# Autodesk Inventor assembly: 3_bar_SCARA_v1
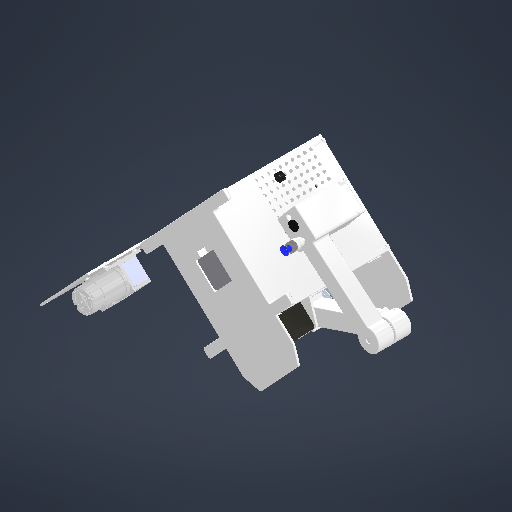
[picture p0: Inventor's stored thumbnail of the model, 512x512]
Saved by Autodesk Inventor 2026 (Build 300175050, 175E)
## iProperties
Created: 2026-10-16
Part Number: 3_bar_SCARA_v1
Document SubType Name: Assembly
Designer: Ваня
Author: Ваня
## Documents named in this file (38)
- C:\Users\VK7\Desktop\SCARA_ETZ_2027\3D Модели\Сборки\3_bar_SCARA_v1.iam
- C:\Users\VK7\Desktop\SCARA_ETZ_2027\3D Модели\Для сборки\Подшипники\pillow_block-KFL08.ipt
- C:\Users\VK7\Desktop\SCARA_ETZ_2027\3D Модели\Для печати\Шкивы\Шкив_GT2_60T_v1.ipt
- C:\Users\VK7\Desktop\SCARA_ETZ_2027\3D Модели\Для печати\Плечи\Плечо_переднее_3BAR.ipt
- C:\Users\VK7\Desktop\SCARA_ETZ_2027\3D Модели\Для сборки\Металл\Вал_алюминиевый_8x30.ipt
- C:\Users\Ваня\Documents\Inventor\Content Center Files\R2025\ru-RU\BS 4168(3)\BS 4168 - M3 x 3(3).ipt
- C:\Users\Ваня\Documents\Inventor\Content Center Files\R2025\ru-RU\AS 1474(1)\AS 1474 - M3(1).ipt
- C:\Users\Ваня\Documents\Inventor\Content Center Files\R2025\ru-RU\AS 1427(05)\AS 1427 - M3 x 16(5) II.ipt
- C:\Users\VK7\Desktop\SCARA_ETZ_2027\3D Модели\Для сборки\Моторы\17HS4401\17HS4401\17HS4401.ipt
- C:\Users\VK7\Desktop\SCARA_ETZ_2027\3D Модели\Для сборки\Подшипники\605-ZZ.ipt
- C:\Users\VK7\Desktop\SCARA_ETZ_2027\3D Модели\Для печати\Плечи\Заглушка_для_переднего_плеча.ipt
- C:\Users\VK7\Desktop\SCARA_ETZ_2027\3D Модели\Для сборки\Подшипники\KDL08_подшипник_без_ободка.ipt
- C:\Users\VK7\Desktop\SCARA_ETZ_2027\3D Модели\Для печати\Плечи\Плечо_дальнее_3BAR.ipt
- C:\Users\VK7\Desktop\SCARA_ETZ_2027\3D Модели\Для печати\Шкивы\Шкив_GT2_40T.ipt
- C:\Users\VK7\Desktop\SCARA_ETZ_2027\3D Модели\Для сборки\Металл\Вал_алюминиевый_8x49.ipt
- C:\Users\VK7\Desktop\SCARA_ETZ_2027\3D Модели\Для печати\Шкивы\Шкив_GT2_20T.ipt
- C:\Users\VK7\Desktop\SCARA_ETZ_2027\3D Модели\Для печати\Ось Z\Крышка_для_оси_Z.ipt
- C:\Users\VK7\Desktop\SCARA_ETZ_2027\3D Модели\Для печати\Ось Z\Платформа_для_оси_Z.ipt
- C:\Users\VK7\Desktop\SCARA_ETZ_2027\3D Модели\Для сборки\Металл\Ползун_для_винта.ipt
- C:\Users\VK7\Desktop\SCARA_ETZ_2027\3D Модели\Для сборки\Подшипники\LM8UU\LM8UU.iam
- C:\Users\VK7\Desktop\SCARA_ETZ_2027\3D Модели\Для сборки\Шкивы\Шкив_GT2_20T.ipt
- C:\Users\VK7\Desktop\SCARA_ETZ_2027\3D Модели\Для сборки\Моторы\Stepper with LeadScrew.ipt
- C:\Users\VK7\Desktop\SCARA_ETZ_2027\3D Модели\Для сборки\Металл\Вал_алюминиевый_8x181.ipt
- C:\Users\VK7\Desktop\SCARA_ETZ_2027\3D Модели\Для печати\Основание\Основа робота.ipt
- C:\Users\VK7\Desktop\SCARA_ETZ_2027\3D Модели\Для печати\Основание\Крышка_верхняя.ipt
- C:\Users\VK7\Desktop\SCARA_ETZ_2027\3D Модели\Для печати\Голова\Крышка_голова_верхняя.ipt
- C:\Users\VK7\Desktop\SCARA_ETZ_2027\3D Модели\Для сборки\Моторы\20HS24\20HS24\20HS24.ipt
- C:\Users\VK7\Desktop\SCARA_ETZ_2027\3D Модели\Для печати\Захват\Трубка.ipt
- C:\Users\VK7\Desktop\SCARA_ETZ_2027\3D Модели\Для сборки\Захват\Присоска\Festo_VAS-15.iam
- C:\Users\VK7\Desktop\SCARA_ETZ_2027\3D Модели\Для печати\Захват\Адаптер_для_присоски.ipt
- C:\Users\VK7\Desktop\SCARA_ETZ_2027\3D Модели\Для сборки\Другое\Камера.ipt
- C:\Users\VK7\Desktop\SCARA_ETZ_2027\3D Модели\Для сборки\Другое\Датчик_расстояния_VL53L0X.ipt
- C:\Users\VK7\Desktop\SCARA_ETZ_2027\3D Модели\Для печати\Голова\Крышка_голова_передняя.ipt
- C:\Users\VK7\Desktop\SCARA_ETZ_2027\3D Модели\Для печати\Основание\Крышка_задняя.ipt
- C:\Users\VK7\Desktop\SCARA_ETZ_2027\3D Модели\Для печати\Другое\Шестерня_для_поворота_присоски_Nema_8.ipt
- C:\Users\VK7\Desktop\SCARA_ETZ_2027\3D Модели\Для печати\Другое\Шестерня_для_поворота_присоски_.ipt
- C:\Users\VK7\Desktop\SCARA_ETZ_2027\3D Модели\Для сборки\Захват\Насос\Mini Vacuum pump-12V.ipt
- C:\Users\VK7\Desktop\SCARA_ETZ_2027\3D Модели\Для печати\Другое\Прокладка_для_насоса_TPU.ipt
## Components (71 placed, 36 different names)
1. Шкив_GT2_60T_v1:1 — С поворотом:2, Совмещение:1, Жесткий:6, Жесткий:7, С поворотом:17, С поворотом:23
2. Плечо_переднее_3BAR:1 — Жесткий:4, С поворотом:2, Совмещение:1, Жесткий:9, Жесткий:10, С поворотом:6, С поворотом:7, Жесткий:13, Жесткий:14, Жесткий:15, С поворотом:17, Жесткий:46, С поворотом:33
3. Вал_алюминиевый_8x30:1 — С поворотом:1, С поворотом:23
4. BS 4168 : Деталь 3 Винты с шестигранным углублением и гаечные ключи. Метрическая серия. - метрическая M3 x 3:2 — Жесткий:5
5. AS 1474 - метрическая M3:1 — Жесткий:4, Жесткий:5
6. pillow_block-KFL08:1 — С поворотом:1, Совмещение:20
7. AS 1474 - метрическая M3:3 — Жесткий:9
8. AS 1427 H - метрическая M3 x 16:3 — Жесткий:6
9. AS 1427 H - метрическая M3 x 16:4 — Жесткий:7
10. AS 1474 - метрическая M3:4 — Жесткий:10
11. 17HS4401:1 — С поворотом:14, С поворотом:16, Совмещение:6, С поворотом:32
12. 605-ZZ:3 — С поворотом:7
13. 605-ZZ:4 — С поворотом:6
14. Заглушка_для_переднего_плеча:1 — Жесткий:46, С поворотом:31
15. KDL08_подшипник_без_ободка:1 — Жесткий:14, Жесткий:16, С поворотом:9, С поворотом:10
16. AS 1474 - метрическая M3:5 — Жесткий:13
17. BS 4168 : Деталь 3 Винты с шестигранным углублением и гаечные ключи. Метрическая серия. - метрическая M3 x 3:3 — Жесткий:15
18. BS 4168 : Деталь 3 Винты с шестигранным углублением и гаечные ключи. Метрическая серия. - метрическая M3 x 3:4 — Жесткий:16
19. Плечо_дальнее_3BAR:1 — Жесткий:18, Жесткий:19, С поворотом:12, С поворотом:13, С поворотом:30, Совмещение:12, Жесткий:44, С поворотом:31, С поворотом:35, Совмещение:19
20. BS 4168 : Деталь 3 Винты с шестигранным углублением и гаечные ключи. Метрическая серия. - метрическая M3 x 3:5 — С поворотом:13
21. AS 1474 - метрическая M3:6 — Жесткий:18
22. AS 1474 - метрическая M3:7 — Жесткий:19
23. Шкив_GT2_40T:1 — Жесткий:17, С поворотом:9
24. BS 4168 : Деталь 3 Винты с шестигранным углублением и гаечные ключи. Метрическая серия. - метрическая M3 x 3:7 — С поворотом:12
25. AS 1474 - метрическая M3:8 — Жесткий:17
26. Вал_алюминиевый_8x49:1 — С поворотом:10
27. Шкив_GT2_20T:1 — С поворотом:14
28. Крышка_для_оси_Z:1 — С поворотом:18, Совмещение:4, С поворотом:19, Жесткий:24, Жесткий:25, Жесткий:26, Жесткий:27, С поворотом:20, Совмещение:9, Совмещение:20, Совмещение:21
29. Платформа_для_оси_Z:1 — Жесткий:20, Жесткий:21, Жесткий:22, Жесткий:23, С поворотом:16, С поворотом:18, Совмещение:4, Совмещение:6, С поворотом:21, Совмещение:7, Цилиндрический:1, Совмещение:8, С поворотом:33, Совмещение:21
30. 17HS4401:2 — С поворотом:19, Совмещение:9
31. LM8UU:1 [sub-assembly] — Жесткий:22
32. LM8UU:2 [sub-assembly] — Жесткий:20
33. LM8UU:3 [sub-assembly] — Жесткий:23
34. LM8UU:4 [sub-assembly] — Жесткий:21
35. AS 1427 H - метрическая M3 x 16:5 — Жесткий:26
36. AS 1427 H - метрическая M3 x 16:6 — Жесткий:25
37. AS 1427 H - метрическая M3 x 16:7 — Жесткий:24
38. AS 1427 H - метрическая M3 x 16:8 — Жесткий:27
39. Шкив_GT2_20T:2 — С поворотом:20
40. Ползун_для_винта:1 — С поворотом:21, Совмещение:7
41. Stepper with LeadScrew:1 — Жесткий:28, С поворотом:24
42. Вал_алюминиевый_8x181:1 — Жесткий:29
43. Вал_алюминиевый_8x181:2 — Жесткий:30, Совмещение:10
44. Вал_алюминиевый_8x181:3 — Жесткий:31, Совмещение:8
45. Основа робота:1 — Жесткий:28, Жесткий:29, Жесткий:30, Жесткий:31, Жесткий:32, Заподлицо:2, Заподлицо:3
46. Вал_алюминиевый_8x181:4 — Жесткий:32, Цилиндрический:1, С поворотом:25
47. Крышка_верхняя:1 — С поворотом:25, Совмещение:10
48. pillow_block-KFL08:2 — С поворотом:24
49. Крышка_голова_верхняя:1 — С поворотом:28, С поворотом:30, Совмещение:12, Жесткий:47
50. 605-ZZ:5 — С поворотом:27
51. 20HS24:1 — Жесткий:47, Жесткий:48
52. Трубка:1 — С поворотом:27, Жесткий:37, Жесткий:43, С поворотом:28, С поворотом:34
53. Festo_VAS-15:1 [sub-assembly] — Жесткий:37, Жесткий:38
54. Адаптер_для_присоски:1 — Жесткий:38, Жесткий:43
55. Камера:1 — Совмещение:13, Совмещение:14, Совмещение:15
56. Датчик_расстояния_VL53L0X:1 — Жесткий:44
57. Крышка_голова_передняя:2 — Заподлицо:1, Совмещение:13, Совмещение:15, С поворотом:35, Совмещение:19
58. 605-ZZ:6 — С поворотом:32
59. Цилиндрическое зубчатое зацепление1:1 — С поворотом:34
60. Цилиндрическое зубчатое зацепление2:1 — Жесткий:48
61. Крышка_задняя:2 — Жесткий:50, Жесткий:58, Жесткий:59, Жесткий:60, Жесткий:61, Жесткий:62, Жесткий:63, Жесткий:64, Жесткий:65
62. Mini Vacuum pump-12V:2 — Жесткий:57, Жесткий:66
63. Прокладка_для_насоса_TPU:4 — Жесткий:50, Жесткий:57
64. Прокладка_для_насоса_TPU:5 — Жесткий:58
65. Прокладка_для_насоса_TPU:6 — Жесткий:59
66. Прокладка_для_насоса_TPU:7 — Жесткий:60
67. Прокладка_для_насоса_TPU:8 — Жесткий:61
68. Прокладка_для_насоса_TPU:9 — Жесткий:63, Жесткий:66
69. Прокладка_для_насоса_TPU:10 — Жесткий:64
70. Прокладка_для_насоса_TPU:11 — Жесткий:65
71. Прокладка_для_насоса_TPU:12 — Жесткий:62
## Relationships (88: WeldJoint 44, RevoluteJoint 26, Mate 14, Flush 3, CylindricalJoint 1)
- С поворотом:1 [RevoluteJoint] (-10.6 mm): Вал_алюминиевый_8x30:1 ↔ pillow_block-KFL08:1
- Жесткий:4 [WeldJoint]: Плечо_переднее_3BAR:1 ↔ AS 1474 - метрическая M3:1
- Жесткий:5 [WeldJoint]: BS 4168 : Деталь 3 Винты с шестигранным углублением и гаечные ключи. Метрическая серия. - метрическая M3 x 3:2 ↔ AS 1474 - метрическая M3:1
- С поворотом:2 [RevoluteJoint]: Шкив_GT2_60T_v1:1 ↔ Плечо_переднее_3BAR:1
- Совмещение:1 [Mate]: Шкив_GT2_60T_v1:1 ↔ Плечо_переднее_3BAR:1
- Жесткий:6 [WeldJoint]: Шкив_GT2_60T_v1:1 ↔ AS 1427 H - метрическая M3 x 16:3
- Жесткий:7 [WeldJoint]: Шкив_GT2_60T_v1:1 ↔ AS 1427 H - метрическая M3 x 16:4
- Жесткий:9 [WeldJoint]: Плечо_переднее_3BAR:1 ↔ AS 1474 - метрическая M3:3
- Жесткий:10 [WeldJoint]: Плечо_переднее_3BAR:1 ↔ AS 1474 - метрическая M3:4
- С поворотом:6 [RevoluteJoint]: Плечо_переднее_3BAR:1 ↔ 605-ZZ:4
- С поворотом:7 [RevoluteJoint]: Плечо_переднее_3BAR:1 ↔ 605-ZZ:3
- Жесткий:13 [WeldJoint]: Плечо_переднее_3BAR:1 ↔ AS 1474 - метрическая M3:5
- Жесткий:14 [WeldJoint]: Плечо_переднее_3BAR:1 ↔ KDL08_подшипник_без_ободка:1
- Жесткий:15 [WeldJoint] (-7 mm): Плечо_переднее_3BAR:1 ↔ BS 4168 : Деталь 3 Винты с шестигранным углублением и гаечные ключи. Метрическая серия. - метрическая M3 x 3:3
- Жесткий:16 [WeldJoint] (-1.5 mm): KDL08_подшипник_без_ободка:1 ↔ BS 4168 : Деталь 3 Винты с шестигранным углублением и гаечные ключи. Метрическая серия. - метрическая M3 x 3:4
- Жесткий:17 [WeldJoint]: Шкив_GT2_40T:1 ↔ AS 1474 - метрическая M3:8
- С поворотом:9 [RevoluteJoint]: KDL08_подшипник_без_ободка:1 ↔ Шкив_GT2_40T:1
- Жесткий:18 [WeldJoint]: Плечо_дальнее_3BAR:1 ↔ AS 1474 - метрическая M3:6
- Жесткий:19 [WeldJoint]: Плечо_дальнее_3BAR:1 ↔ AS 1474 - метрическая M3:7
- С поворотом:10 [RevoluteJoint] (-10 mm): KDL08_подшипник_без_ободка:1 ↔ Вал_алюминиевый_8x49:1
- С поворотом:12 [RevoluteJoint] (-2 mm): Плечо_дальнее_3BAR:1 ↔ BS 4168 : Деталь 3 Винты с шестигранным углублением и гаечные ключи. Метрическая серия. - метрическая M3 x 3:7
- С поворотом:13 [RevoluteJoint] (-2 mm): Плечо_дальнее_3BAR:1 ↔ BS 4168 : Деталь 3 Винты с шестигранным углублением и гаечные ключи. Метрическая серия. - метрическая M3 x 3:5
- С поворотом:14 [RevoluteJoint] (-10.9 mm): 17HS4401:1 ↔ Шкив_GT2_20T:1
- Жесткий:20 [WeldJoint]: Платформа_для_оси_Z:1 ↔ LM8UU:2
- Жесткий:21 [WeldJoint]: Платформа_для_оси_Z:1 ↔ LM8UU:4
- Жесткий:22 [WeldJoint]: Платформа_для_оси_Z:1 ↔ LM8UU:1
- Жесткий:23 [WeldJoint]: Платформа_для_оси_Z:1 ↔ LM8UU:3
- С поворотом:16 [RevoluteJoint]: 17HS4401:1 ↔ Платформа_для_оси_Z:1
- С поворотом:17 [RevoluteJoint]: Шкив_GT2_60T_v1:1 ↔ Плечо_переднее_3BAR:1
- С поворотом:18 [RevoluteJoint]: Крышка_для_оси_Z:1 ↔ Платформа_для_оси_Z:1
- Совмещение:4 [Mate]: Крышка_для_оси_Z:1 ↔ Платформа_для_оси_Z:1
- С поворотом:19 [RevoluteJoint]: Крышка_для_оси_Z:1 ↔ 17HS4401:2
- Жесткий:24 [WeldJoint]: Крышка_для_оси_Z:1 ↔ AS 1427 H - метрическая M3 x 16:7
- Жесткий:25 [WeldJoint]: Крышка_для_оси_Z:1 ↔ AS 1427 H - метрическая M3 x 16:6
- Жесткий:26 [WeldJoint]: Крышка_для_оси_Z:1 ↔ AS 1427 H - метрическая M3 x 16:5
- Жесткий:27 [WeldJoint]: Крышка_для_оси_Z:1 ↔ AS 1427 H - метрическая M3 x 16:8
- С поворотом:20 [RevoluteJoint] (11.7 mm): Крышка_для_оси_Z:1 ↔ Шкив_GT2_20T:2
- Совмещение:6 [Mate]: 17HS4401:1 ↔ Платформа_для_оси_Z:1
- С поворотом:21 [RevoluteJoint]: Платформа_для_оси_Z:1 ↔ Ползун_для_винта:1
- Совмещение:7 [Mate]: Платформа_для_оси_Z:1 ↔ Ползун_для_винта:1
- Жесткий:28 [WeldJoint]: Stepper with LeadScrew:1 ↔ Основа робота:1
- Жесткий:29 [WeldJoint]: Вал_алюминиевый_8x181:1 ↔ Основа робота:1
- Жесткий:30 [WeldJoint]: Вал_алюминиевый_8x181:2 ↔ Основа робота:1
- Жесткий:31 [WeldJoint]: Вал_алюминиевый_8x181:3 ↔ Основа робота:1
- Жесткий:32 [WeldJoint]: Основа робота:1 ↔ Вал_алюминиевый_8x181:4
- С поворотом:23 [RevoluteJoint] (-17.6 mm): Шкив_GT2_60T_v1:1 ↔ Вал_алюминиевый_8x30:1
- Цилиндрический:1 [CylindricalJoint]: Платформа_для_оси_Z:1 ↔ Вал_алюминиевый_8x181:4
- Совмещение:8 [Mate]: Платформа_для_оси_Z:1 ↔ Вал_алюминиевый_8x181:3
- Совмещение:9 [Mate]: Крышка_для_оси_Z:1 ↔ 17HS4401:2
- С поворотом:24 [RevoluteJoint] (0.7 mm): Stepper with LeadScrew:1 ↔ pillow_block-KFL08:2
- С поворотом:25 [RevoluteJoint] (1 mm): Вал_алюминиевый_8x181:4 ↔ Крышка_верхняя:1
- Совмещение:10 [Mate]: Вал_алюминиевый_8x181:2 ↔ Крышка_верхняя:1
- С поворотом:27 [RevoluteJoint]: 605-ZZ:5 ↔ Трубка:1
- Жесткий:37 [WeldJoint]: Трубка:1 ↔ Festo_VAS-15:1
- Жесткий:38 [WeldJoint]: Festo_VAS-15:1 ↔ Адаптер_для_присоски:1
- Жесткий:43 [WeldJoint] (5 mm): Трубка:1 ↔ Адаптер_для_присоски:1
- С поворотом:28 [RevoluteJoint]: Крышка_голова_верхняя:1 ↔ Трубка:1
- С поворотом:30 [RevoluteJoint]: Плечо_дальнее_3BAR:1 ↔ Крышка_голова_верхняя:1
- Совмещение:12 [Mate]: Плечо_дальнее_3BAR:1 ↔ Крышка_голова_верхняя:1
- Жесткий:44 [WeldJoint]: Плечо_дальнее_3BAR:1 ↔ Датчик_расстояния_VL53L0X:1
- Заподлицо:1 [Flush] (0.5 mm): Крышка_голова_передняя:2
- Совмещение:13 [Mate]: Камера:1 ↔ Крышка_голова_передняя:2
- Совмещение:14 [Mate]: Камера:1
- Совмещение:15 [Mate]: Камера:1 ↔ Крышка_голова_передняя:2
- Жесткий:46 [WeldJoint]: Плечо_переднее_3BAR:1 ↔ Заглушка_для_переднего_плеча:1
- С поворотом:31 [RevoluteJoint] (2 mm): Заглушка_для_переднего_плеча:1 ↔ Плечо_дальнее_3BAR:1
- С поворотом:32 [RevoluteJoint] (0.2 mm): 17HS4401:1 ↔ 605-ZZ:6
- С поворотом:33 [RevoluteJoint] (1.6 mm): Плечо_переднее_3BAR:1 ↔ Платформа_для_оси_Z:1
- Жесткий:47 [WeldJoint]: Крышка_голова_верхняя:1 ↔ 20HS24:1
- Заподлицо:2 [Flush] (0.1 mm): Основа робота:1
- Заподлицо:3 [Flush] (0.1 mm): Основа робота:1
- Жесткий:48 [WeldJoint] (-5 mm): 20HS24:1 ↔ Цилиндрическое зубчатое зацепление2:1
- С поворотом:34 [RevoluteJoint] (-28.15 mm): Трубка:1 ↔ Цилиндрическое зубчатое зацепление1:1
- С поворотом:35 [RevoluteJoint]: Плечо_дальнее_3BAR:1 ↔ Крышка_голова_передняя:2
- Совмещение:19 [Mate]: Плечо_дальнее_3BAR:1 ↔ Крышка_голова_передняя:2
- Жесткий:50 [WeldJoint]: Крышка_задняя:2 ↔ Прокладка_для_насоса_TPU:4
- Жесткий:57 [WeldJoint]: Mini Vacuum pump-12V:2 ↔ Прокладка_для_насоса_TPU:4
- Жесткий:58 [WeldJoint]: Крышка_задняя:2 ↔ Прокладка_для_насоса_TPU:5
- Жесткий:59 [WeldJoint]: Крышка_задняя:2 ↔ Прокладка_для_насоса_TPU:6
- Жесткий:60 [WeldJoint]: Крышка_задняя:2 ↔ Прокладка_для_насоса_TPU:7
- Жесткий:61 [WeldJoint]: Крышка_задняя:2 ↔ Прокладка_для_насоса_TPU:8
- Жесткий:62 [WeldJoint]: Крышка_задняя:2 ↔ Прокладка_для_насоса_TPU:12
- Жесткий:63 [WeldJoint]: Крышка_задняя:2 ↔ Прокладка_для_насоса_TPU:9
- Жесткий:64 [WeldJoint]: Крышка_задняя:2 ↔ Прокладка_для_насоса_TPU:10
- Жесткий:65 [WeldJoint]: Крышка_задняя:2 ↔ Прокладка_для_насоса_TPU:11
- Жесткий:66 [WeldJoint]: Mini Vacuum pump-12V:2 ↔ Прокладка_для_насоса_TPU:9
- Совмещение:20 [Mate]: pillow_block-KFL08:1 ↔ Крышка_для_оси_Z:1
- Совмещение:21 [Mate]: Крышка_для_оси_Z:1 ↔ Платформа_для_оси_Z:1
